# Autodesk Inventor assembly: UDP_w5500
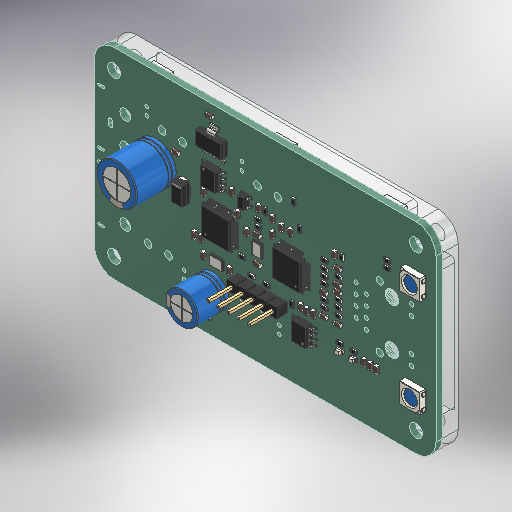
[picture p0: Inventor's stored thumbnail of the model, 512x512]
Saved by Autodesk Inventor 2025.3 (Build 293356030, 356C)
## iProperties
Company: Kicad
Created: 2026-02-13
Part Number: UDP_w5500
Description: KiCad electronic assembly
Document SubType Name: Assembly
Designer: ibuki_ono
Authority: Unknown
Sending System: KiCad to STEP converter
Preprocessor: Open CASCADE STEP processor 7.9
Title: UDP_w5500.step
Author: Pcbnew
## Documents named in this file (18)
- C:\Users\ibuki_ono\Documents\hobby\rogiken\catchrobo\2026_CAD\Hardware_2026\Inventor\base_table\UDP_w5500\UDP_w5500\UDP_w5500.iam
- C:\Users\ibuki_ono\Documents\hobby\rogiken\catchrobo\2026_CAD\Hardware_2026\Inventor\base_table\UDP_w5500\UDP_w5500\C_0603_1608Metric.ipt
- C:\Users\ibuki_ono\Documents\hobby\rogiken\catchrobo\2026_CAD\Hardware_2026\Inventor\base_table\UDP_w5500\UDP_w5500\R_0603_1608Metric.ipt
- C:\Users\ibuki_ono\Documents\hobby\rogiken\catchrobo\2026_CAD\Hardware_2026\Inventor\base_table\UDP_w5500\UDP_w5500\CP_Radial_D10.0mm_P5.00mm.ipt
- C:\Users\ibuki_ono\Documents\hobby\rogiken\catchrobo\2026_CAD\Hardware_2026\Inventor\base_table\UDP_w5500\UDP_w5500\Crystal_SMD_3225-4Pin_3.2x2.5mm.ipt
- C:\Users\ibuki_ono\Documents\hobby\rogiken\catchrobo\2026_CAD\Hardware_2026\Inventor\base_table\UDP_w5500\UDP_w5500\LED_0603_1608Metric.ipt
- C:\Users\ibuki_ono\Documents\hobby\rogiken\catchrobo\2026_CAD\Hardware_2026\Inventor\base_table\UDP_w5500\UDP_w5500\L_0603_1608Metric.ipt
- C:\Users\ibuki_ono\Documents\hobby\rogiken\catchrobo\2026_CAD\Hardware_2026\Inventor\base_table\UDP_w5500\UDP_w5500\SOT-223.ipt
- C:\Users\ibuki_ono\Documents\hobby\rogiken\catchrobo\2026_CAD\Hardware_2026\Inventor\base_table\UDP_w5500\UDP_w5500\SOIC-8_3.9x4.9mm_P1.27mm.ipt
- C:\Users\ibuki_ono\Documents\hobby\rogiken\catchrobo\2026_CAD\Hardware_2026\Inventor\base_table\UDP_w5500\UDP_w5500\LED_WS2812B_PLCC4_5.0x5.0mm_P3.2mm.ipt
- C:\Users\ibuki_ono\Documents\hobby\rogiken\catchrobo\2026_CAD\Hardware_2026\Inventor\base_table\UDP_w5500\UDP_w5500\SOT-23-5.ipt
- C:\Users\ibuki_ono\Documents\hobby\rogiken\catchrobo\2026_CAD\Hardware_2026\Inventor\base_table\UDP_w5500\UDP_w5500\LQFP-48_7x7mm_P0.5mm.ipt
- C:\Users\ibuki_ono\Documents\hobby\rogiken\catchrobo\2026_CAD\Hardware_2026\Inventor\base_table\UDP_w5500\UDP_w5500\PinHeader_1x05_P2.54mm_Vertical.ipt
- C:\Users\ibuki_ono\Documents\hobby\rogiken\catchrobo\2026_CAD\Hardware_2026\Inventor\base_table\UDP_w5500\UDP_w5500\CP_Radial_D8.0mm_P3.50mm.ipt
- C:\Users\ibuki_ono\Documents\hobby\rogiken\catchrobo\2026_CAD\Hardware_2026\Inventor\base_table\UDP_w5500\UDP_w5500\R_1206_3216Metric.ipt
- C:\Users\ibuki_ono\Documents\hobby\rogiken\catchrobo\2026_CAD\Hardware_2026\Inventor\base_table\UDP_w5500\UDP_w5500\D_SMA.ipt
- C:\Users\ibuki_ono\Documents\hobby\rogiken\catchrobo\2026_CAD\Hardware_2026\Inventor\base_table\UDP_w5500\UDP_w5500\UDP_w5500_PCB.ipt
- C:\Users\ibuki_ono\Documents\hobby\rogiken\catchrobo\2026_CAD\Hardware_2026\Inventor\base_table\3D_clear.ipt
## Components (79 placed, 79 different names)
1. 1
2. 2
3. 3
4. 4
5. 5
6. 6
7. 7
8. 8
9. 9
10. 10
11. 11
12. 12
13. 13
14. 14
15. 15
16. 16
17. 17
18. 18
19. 19
20. 20
21. 21
22. 22
23. 23
24. 24
25. 25
26. 26
27. 27
28. 28
29. 29
30. 30
31. 31
32. 32
33. 33
34. 34
35. 35
36. 36
37. 37
38. 38
39. 39
40. 40
41. 41
42. 42
43. 43
44. 44
45. 45
46. 46
47. 47
48. 48
49. 49
50. 50
51. 51
52. 52
53. 53
54. 54
55. 55
56. 56
57. 57
58. 58
59. 59
60. 60
61. 61
62. 62
63. 63
64. 64
65. 65
66. 66
67. 67
68. 68
69. 69
70. 70
71. 71
72. 72
73. 73
74. 74
75. 75
76. 76
77. 77
78. 78 — 挿入:1, 角度:1
79. 3D_clear:1 — 挿入:1, 角度:1
## Relationships (2: Insert 1, Angle 1)
- 挿入:1 [Insert]: 78 ↔ 3D_clear:1
- 角度:1 [Angle] (0 deg): 78 ↔ 3D_clear:1
